# Autodesk Inventor assembly: assemblage fonctionnel
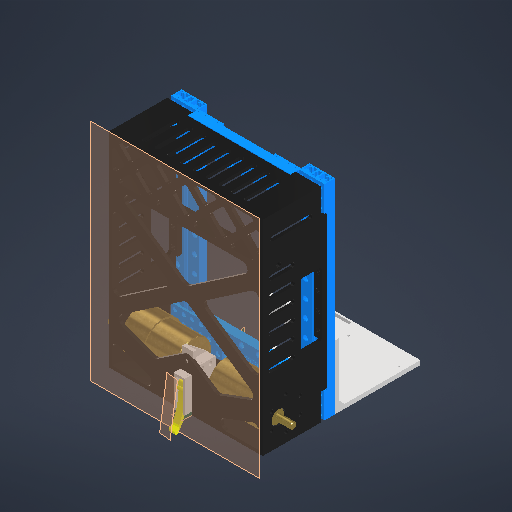
[picture p0: Inventor's stored thumbnail of the model, 512x512]
Saved by Autodesk Inventor 2026 (Build 300175000, 175)
## iProperties
Created: 2025-06-23
Part Number: assemblage fonctionnel
Document SubType Name: Assembly
Designer: virgi
Author: virgi
## Documents named in this file (6)
- C:\Users\virgi\OneDrive - HESSO\Fichiers de Guerinet Rémi - P2511_Dossier_partage_RVEZ\01_Robot\0101_CAO\0_Châssis\01_Petit Châssis\assemblage fonctionnel.iam
- C:\Users\virgi\OneDrive - HESSO\Fichiers de Guerinet Rémi - P2511_Dossier_partage_RVEZ\01_Robot\0101_CAO\0_Châssis\01_Petit Châssis\01_ASM_Chassis_proto.iam
- C:\Users\virgi\OneDrive - HESSO\Fichiers de Guerinet Rémi - P2511_Dossier_partage_RVEZ\01_Robot\0101_CAO\0_Châssis\01_Petit Châssis\01_4_2_support_electronique_moteur_v2.ipt
- C:\Users\virgi\OneDrive - HESSO\Fichiers de Guerinet Rémi - P2511_Dossier_partage_RVEZ\01_Robot\0101_CAO\Moteur\Modelcraft RB350030-0A101R\Modelcraft RB350030-0A101R\Modelcraft RB350030-0A101R.ipt
- C:\Users\virgi\OneDrive - HESSO\Fichiers de Guerinet Rémi - P2511_Dossier_partage_RVEZ\01_Robot\0101_CAO\6_Detection\6_11_asm_detection3.iam
- C:\Users\virgi\OneDrive - HESSO\Fichiers de Guerinet Rémi - P2511_Dossier_partage_RVEZ\01_Robot\0101_CAO\0_Châssis\01_Petit Châssis\01_4_3_support_electronique.ipt
## Components (6 placed, 5 different names)
1. 01_ASM_Chassis_proto:1 [sub-assembly] — Placage:1, Affleurement:1, Affleurement:2, Placage:11, Affleurement:3, Placage:12
2. 01_4_2_support_electronique_moteur_v2:1 — Placage:1, Affleurement:1, Affleurement:2, Placage:2, Placage:3, Placage:4, Placage:5, Placage:6, Placage:7, Placage:8, Placage:9, Placage:10
3. Modelcraft RB350030-0A101R:2 — Placage:2, Placage:3, Placage:4
4. Modelcraft RB350030-0A101R:3 — Placage:5, Placage:6, Placage:7
5. 6_11_asm_detection3:1 [sub-assembly] — Placage:8, Placage:9, Placage:10
6. 01_4_3_support_electronique:1 — Placage:11, Affleurement:3, Placage:12
## Relationships (15: Mate 12, Flush 3)
- Placage:1 [Mate]: 01_ASM_Chassis_proto:1 ↔ 01_4_2_support_electronique_moteur_v2:1
- Affleurement:1 [Flush]: 01_ASM_Chassis_proto:1 ↔ 01_4_2_support_electronique_moteur_v2:1
- Affleurement:2 [Flush]: 01_ASM_Chassis_proto:1 ↔ 01_4_2_support_electronique_moteur_v2:1
- Placage:2 [Mate]: 01_4_2_support_electronique_moteur_v2:1 ↔ Modelcraft RB350030-0A101R:2
- Placage:3 [Mate]: 01_4_2_support_electronique_moteur_v2:1 ↔ Modelcraft RB350030-0A101R:2
- Placage:4 [Mate] (4 mm): 01_4_2_support_electronique_moteur_v2:1 ↔ Modelcraft RB350030-0A101R:2
- Placage:5 [Mate]: 01_4_2_support_electronique_moteur_v2:1 ↔ Modelcraft RB350030-0A101R:3
- Placage:6 [Mate]: 01_4_2_support_electronique_moteur_v2:1 ↔ Modelcraft RB350030-0A101R:3
- Placage:7 [Mate] (4 mm): 01_4_2_support_electronique_moteur_v2:1 ↔ Modelcraft RB350030-0A101R:3
- Placage:8 [Mate]: 01_4_2_support_electronique_moteur_v2:1 ↔ 6_11_asm_detection3:1
- Placage:9 [Mate]: 01_4_2_support_electronique_moteur_v2:1 ↔ 6_11_asm_detection3:1
- Placage:10 [Mate]: 01_4_2_support_electronique_moteur_v2:1 ↔ 6_11_asm_detection3:1
- Placage:11 [Mate]: 01_ASM_Chassis_proto:1 ↔ 01_4_3_support_electronique:1
- Affleurement:3 [Flush]: 01_ASM_Chassis_proto:1 ↔ 01_4_3_support_electronique:1
- Placage:12 [Mate]: 01_ASM_Chassis_proto:1 ↔ 01_4_3_support_electronique:1
